# Autodesk Inventor assembly: full_layout_test_2
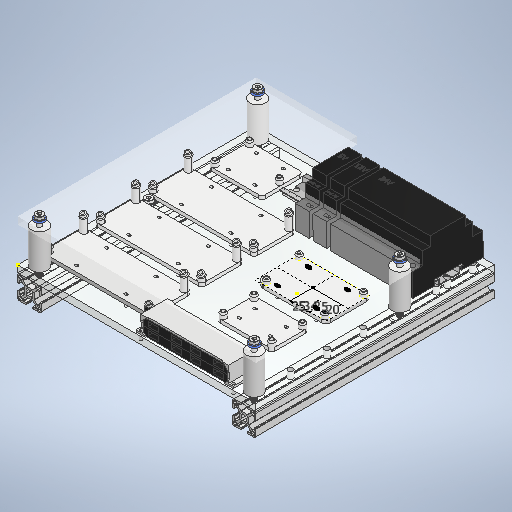
[picture p0: Inventor's stored thumbnail of the model, 512x512]
Saved by Autodesk Inventor 2025.1 (Build 291241000, 241)
## iProperties
Created: 2026-10-19
Part Number: full_layout_test_2
Document SubType Name: Assembly
Designer: Aiden Shaevitz
Author: Aiden Shaevitz
## Documents named in this file (17)
- C:\Users\Aiden Shaevitz\Documents\GitHub\coldex-instrumentation\3d_models\mounting_hardware\dummy_parts\full_layout_test_2.iam
- C:\Users\Aiden Shaevitz\Documents\GitHub\coldex-instrumentation\3d_models\mounting_hardware\dummy_parts\acrylic_base_2.ipt
- C:\Users\Aiden Shaevitz\Documents\GitHub\coldex-instrumentation\3d_models\mounting_hardware\dummy_parts\din_rail_200mm.ipt
- C:\Users\Aiden Shaevitz\Documents\GitHub\coldex-instrumentation\3d_models\mounting_hardware\dummy_parts\24V_din_pwr_supply.ipt
- C:\Users\Aiden Shaevitz\Documents\GitHub\coldex-instrumentation\3d_models\mounting_hardware\dummy_parts\12V_din_voltage_regulator.ipt
- C:\Users\Aiden Shaevitz\Documents\GitHub\coldex-instrumentation\3d_models\mounting_hardware\dummy_parts\5V_din_voltage_regulator.ipt
- C:\Users\Aiden Shaevitz\Documents\GitHub\coldex-instrumentation\3d_models\mounting_hardware\McMaster\30mm_1ft_T-Slotted Framing.ipt
- C:\Users\Aiden Shaevitz\Documents\GitHub\coldex-instrumentation\3d_models\mounting_hardware\dummy_parts\acrylic_cover_2.ipt
- C:\Users\Aiden Shaevitz\Documents\GitHub\coldex-instrumentation\3d_models\mounting_hardware\dummy_parts\anker_4-port_usb3.0_splitter.ipt
- C:\Users\Aiden Shaevitz\Documents\GitHub\coldex-instrumentation\3d_models\mounting_hardware\dummy_parts\anker_usb_hub_clamp.ipt
- C:\Users\Aiden Shaevitz\Documents\GitHub\coldex-instrumentation\3d_models\mounting_hardware\dummy_parts\m6_70mm_t-slot_bolt_assembly.iam
- C:\Users\Aiden Shaevitz\Documents\GitHub\coldex-instrumentation\3d_models\mounting_hardware\dummy_parts\spacer_temp.ipt
- C:\Users\Aiden Shaevitz\Documents\GitHub\coldex-instrumentation\3d_models\mounting_hardware\dummy_parts\m6_18mm_t-slot_bolt_assembly.iam
- C:\Users\Aiden Shaevitz\Documents\GitHub\coldex-instrumentation\3d_models\mounting_hardware\dummy_parts\relay_module_standoffs_angled_plate_m3.ipt
- C:\Users\Aiden Shaevitz\Documents\GitHub\coldex-instrumentation\3d_models\mounting_hardware\dummy_parts\arduino_mega_standoffs_plate_m3.ipt
- C:\Users\Aiden Shaevitz\Documents\GitHub\coldex-instrumentation\3d_models\mounting_hardware\dummy_parts\proto-board_standoffs_plate_m3.ipt
- C:\Users\Aiden Shaevitz\Documents\GitHub\coldex-instrumentation\3d_models\mounting_hardware\dummy_parts\db-25_standoffs_plate_m3.ipt
## Components (26 placed, 16 different names)
1. acrylic_base_2:1 — Mate:1, Mate:2, Angle:1, Mate:10, Mate:11, Flush:2, Flush:3, Flush:4, Flush:5, Mate:42, Angle:4, Flush:9, Flush:10, Mate:50, Mate:51, Mate:53, Mate:55, Mate:56, Mate:58, Mate:60, Mate:62, Mate:68, Mate:69, Mate:70, Mate:71, Mate:72
2. din_rail_200mm:1 — Mate:1, Mate:2, Angle:1, Mate:3, Mate:4, Mate:5, Mate:6, Mate:7, Mate:8, Flush:1
3. 24V_din_pwr_supply:1 — Mate:3, Mate:4, Flush:1, Mate:32
4. 12V_din_voltage_regulator:1 — Mate:5, Mate:8, Mate:32, Mate:33
5. 5V_din_voltage_regulator:1 — Mate:6, Mate:7, Mate:33
6. 30mm_1ft_T-Slotted Framing:1 — Mate:11, Flush:2, Flush:3, Mate:52, Mate:54
7. 30mm_1ft_T-Slotted Framing:2 — Mate:10, Flush:4, Flush:5, Mate:48, Mate:49, Mate:67, Angle:5
8. acrylic_cover_2:1 — Flush:9, Flush:10, Mate:64
9. anker_4-port_usb3.0_splitter:1 — Mate:42, Angle:4, Mate:47, Flush:6, Flush:7
10. anker_4-port_usb3.0_splitter:2 — Mate:47, Flush:6, Flush:7, Flush:8
11. anker_usb_hub_clamp:1 — Flush:8
12. m6_70mm_t-slot_bolt_assembly:1 [sub-assembly] — Mate:52, Mate:53, Mate:59
13. m6_70mm_t-slot_bolt_assembly:2 [sub-assembly] — Mate:49, Mate:50, Mate:57
14. m6_70mm_t-slot_bolt_assembly:3 [sub-assembly] — Mate:48, Mate:51, Mate:61
15. m6_70mm_t-slot_bolt_assembly:4 [sub-assembly] — Mate:54, Mate:55, Mate:63
16. spacer_temp:1 — Mate:58, Mate:59
17. spacer_temp:2 — Mate:56, Mate:57
18. spacer_temp:3 — Mate:60, Mate:61, Mate:64
19. spacer_temp:4 — Mate:62, Mate:63
20. m6_18mm_t-slot_bolt_assembly:1 [sub-assembly] — Mate:67, Mate:68
21. arduino_mega_standoffs_plate_m3:1 — Mate:71
22. proto-board_standoffs_plate_m3:1 — Mate:70
23. db-25_standoffs_plate_m3:1 — Mate:72
24. relay_module_standoffs_angled_plate_m3:1 — Mate:69, Angle:5
25. relay_module_standoffs_angled_plate_m3:2
26. relay_module_standoffs_angled_plate_m3:3
## Component patterns: (3 elements, first: relay_module_standoffs_angled_plate_m3:1)
## Relationships (50: Mate 37, Flush 10, Angle 3)
- Mate:1: acrylic_base_2:1 ↔ din_rail_200mm:1
- Mate:2: acrylic_base_2:1 ↔ din_rail_200mm:1
- Angle:1 (0 deg): acrylic_base_2:1 ↔ din_rail_200mm:1
- Mate:3: din_rail_200mm:1 ↔ 24V_din_pwr_supply:1
- Mate:4: din_rail_200mm:1 ↔ 24V_din_pwr_supply:1
- Mate:5: din_rail_200mm:1 ↔ 12V_din_voltage_regulator:1
- Mate:6: din_rail_200mm:1 ↔ 5V_din_voltage_regulator:1
- Mate:7: din_rail_200mm:1 ↔ 5V_din_voltage_regulator:1
- Mate:8: din_rail_200mm:1 ↔ 12V_din_voltage_regulator:1
- Mate:10: acrylic_base_2:1 ↔ 30mm_1ft_T-Slotted Framing:2
- Mate:11: acrylic_base_2:1 ↔ 30mm_1ft_T-Slotted Framing:1
- Flush:1 (-2 mm): din_rail_200mm:1 ↔ 24V_din_pwr_supply:1
- Flush:2: acrylic_base_2:1 ↔ 30mm_1ft_T-Slotted Framing:1
- Flush:3: acrylic_base_2:1 ↔ 30mm_1ft_T-Slotted Framing:1
- Flush:4: acrylic_base_2:1 ↔ 30mm_1ft_T-Slotted Framing:2
- Flush:5: acrylic_base_2:1 ↔ 30mm_1ft_T-Slotted Framing:2
- Mate:32 (5 mm): 24V_din_pwr_supply:1 ↔ 12V_din_voltage_regulator:1
- Mate:33 (5 mm): 12V_din_voltage_regulator:1 ↔ 5V_din_voltage_regulator:1
- Mate:42: acrylic_base_2:1 ↔ anker_4-port_usb3.0_splitter:1
- Angle:4 (0 deg): acrylic_base_2:1 ↔ anker_4-port_usb3.0_splitter:1
- Mate:47: anker_4-port_usb3.0_splitter:1 ↔ anker_4-port_usb3.0_splitter:2
- Flush:6: anker_4-port_usb3.0_splitter:1 ↔ anker_4-port_usb3.0_splitter:2
- Flush:7: anker_4-port_usb3.0_splitter:1 ↔ anker_4-port_usb3.0_splitter:2
- Flush:8: anker_4-port_usb3.0_splitter:2 ↔ anker_usb_hub_clamp:1
- Flush:9: acrylic_base_2:1 ↔ acrylic_cover_2:1
- Flush:10: acrylic_base_2:1 ↔ acrylic_cover_2:1
- Mate:48: 30mm_1ft_T-Slotted Framing:2 ↔ m6_70mm_t-slot_bolt_assembly:3
- Mate:49: 30mm_1ft_T-Slotted Framing:2 ↔ m6_70mm_t-slot_bolt_assembly:2
- Mate:50: acrylic_base_2:1 ↔ m6_70mm_t-slot_bolt_assembly:2
- Mate:51: acrylic_base_2:1 ↔ m6_70mm_t-slot_bolt_assembly:3
- Mate:52: 30mm_1ft_T-Slotted Framing:1 ↔ m6_70mm_t-slot_bolt_assembly:1
- Mate:53: acrylic_base_2:1 ↔ m6_70mm_t-slot_bolt_assembly:1
- Mate:54: 30mm_1ft_T-Slotted Framing:1 ↔ m6_70mm_t-slot_bolt_assembly:4
- Mate:55: acrylic_base_2:1 ↔ m6_70mm_t-slot_bolt_assembly:4
- Mate:56: acrylic_base_2:1 ↔ spacer_temp:2
- Mate:57: m6_70mm_t-slot_bolt_assembly:2 ↔ spacer_temp:2
- Mate:58: acrylic_base_2:1 ↔ spacer_temp:1
- Mate:59: m6_70mm_t-slot_bolt_assembly:1 ↔ spacer_temp:1
- Mate:60: acrylic_base_2:1 ↔ spacer_temp:3
- Mate:61: m6_70mm_t-slot_bolt_assembly:3 ↔ spacer_temp:3
- Mate:62: acrylic_base_2:1 ↔ spacer_temp:4
- Mate:63: m6_70mm_t-slot_bolt_assembly:4 ↔ spacer_temp:4
- Mate:64: acrylic_cover_2:1 ↔ spacer_temp:3
- Mate:67: 30mm_1ft_T-Slotted Framing:2 ↔ m6_18mm_t-slot_bolt_assembly:1
- Mate:68: acrylic_base_2:1 ↔ m6_18mm_t-slot_bolt_assembly:1
- Mate:69: acrylic_base_2:1 ↔ relay_module_standoffs_angled_plate_m3:1
- Angle:5 (0 deg): 30mm_1ft_T-Slotted Framing:2 ↔ relay_module_standoffs_angled_plate_m3:1
- Mate:70: acrylic_base_2:1 ↔ proto-board_standoffs_plate_m3:1
- Mate:71: acrylic_base_2:1 ↔ arduino_mega_standoffs_plate_m3:1
- Mate:72: acrylic_base_2:1 ↔ db-25_standoffs_plate_m3:1
